# Autodesk Inventor assembly: iterasi4-fullpart
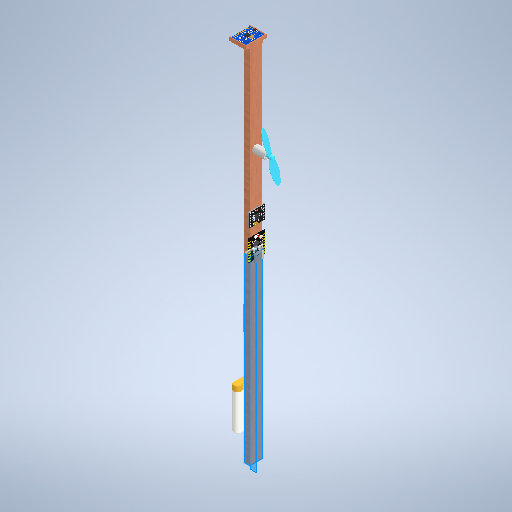
[picture p0: Inventor's stored thumbnail of the model, 512x512]
Saved by Autodesk Inventor 2026.2 (Build 302298010, 298A)
## iProperties
Created: 2026-11-17
Part Number: iterasi4-fullpart
Document SubType Name: Assembly
Designer: Acer
Author: Acer
## Documents named in this file (10)
- D:\Cool Yeah\Semester 3\Praktikum SKD\Projek-Akhir\3Dmodel\iterasi4-fullpart.iam
- D:\Cool Yeah\Semester 3\Praktikum SKD\Projek-Akhir\3Dmodel\iterasi4.ipt
- D:\Cool Yeah\Semester 3\Praktikum SKD\Projek-Akhir\3Dmodel\iterasi4-part2.ipt
- D:\Cool Yeah\Semester 3\Praktikum SKD\Projek-Akhir\3Dmodel\makerfocus-1100mah-lipo-battery-1.snapshot.1\1100mAh lipo v8\1100mAh lipo v8\1100mAh lipo v8.ipt
- D:\Cool Yeah\Semester 3\Praktikum SKD\Projek-Akhir\3Dmodel\drv8833-motor-driver-1.snapshot.2\DRV8833\DRV8833\DRV8833.ipt
- D:\Cool Yeah\Semester 3\Praktikum SKD\Projek-Akhir\3Dmodel\mc-esp32-c3-super-mini-black-pink-red-1.snapshot.21\ESP32 C3 Super mini\ESP32 C3 Super mini\ESP32 C3 Super mini.ipt
- D:\Cool Yeah\Semester 3\Praktikum SKD\Projek-Akhir\3Dmodel\tp4056-2.snapshot.2\TP4056\TP4056\TP4056.ipt
- D:\Cool Yeah\Semester 3\Praktikum SKD\Projek-Akhir\3Dmodel\8520-coreless-brushed-motor-1.snapshot.2\8520 Coreless Brshed motor\8520 Coreless Brshed motor\8520 Coreless Brshed motor.ipt
- D:\Cool Yeah\Semester 3\Praktikum SKD\Projek-Akhir\3Dmodel\propeller-65-mm-helice-65mm-1.snapshot.5\helice-ccw-65mm\helice-ccw-65mm\helice-ccw-65mm.ipt
- D:\Cool Yeah\Semester 3\Praktikum SKD\Projek-Akhir\3Dmodel\MPU6050\MPU6050 Accelerometer\MPU6050 Accelerometer\MPU6050 Accelerometer.ipt
## Components (9 placed, 9 different names)
1. iterasi4:1 — Mate:1, Flush:1, Flush:2, Insert:1, Mate:3, Flush:4, Mate:4, Mate:7, Mate:8, Mate:9
2. iterasi4-part2:1 — Mate:1, Flush:1, Flush:2, Mate:2, Flush:3, Mate:6
3. 1100mAh lipo v8:1 — Mate:2, Flush:3
4. DRV8833:1 — Mate:3, Flush:4, Mate:5
5. ESP32 C3 Super mini:1 — Mate:4, Mate:5
6. TP4056:2 — Mate:6
7. 8520 Coreless Brshed motor:1 — Insert:1, Insert:2
8. helice-ccw-65mm:1 — Insert:2
9. MPU6050 Accelerometer:1 — Mate:7, Mate:8, Mate:9
## Relationships (15: Mate 9, Flush 4, Insert 2)
- Mate:1: iterasi4:1 ↔ iterasi4-part2:1
- Flush:1: iterasi4:1 ↔ iterasi4-part2:1
- Flush:2: iterasi4:1 ↔ iterasi4-part2:1
- Mate:2: iterasi4-part2:1 ↔ 1100mAh lipo v8:1
- Flush:3 (30 mm): iterasi4-part2:1 ↔ 1100mAh lipo v8:1
- Insert:1: iterasi4:1 ↔ 8520 Coreless Brshed motor:1
- Insert:2: 8520 Coreless Brshed motor:1 ↔ helice-ccw-65mm:1
- Mate:3: iterasi4:1 ↔ DRV8833:1
- Flush:4 (160 mm): iterasi4:1 ↔ DRV8833:1
- Mate:4: iterasi4:1 ↔ ESP32 C3 Super mini:1
- Mate:5 (10 mm): DRV8833:1 ↔ ESP32 C3 Super mini:1
- Mate:6: iterasi4-part2:1 ↔ TP4056:2
- Mate:7: iterasi4:1 ↔ MPU6050 Accelerometer:1
- Mate:8: iterasi4:1 ↔ MPU6050 Accelerometer:1
- Mate:9: iterasi4:1 ↔ MPU6050 Accelerometer:1
